# Autodesk Inventor assembly: Assembly1
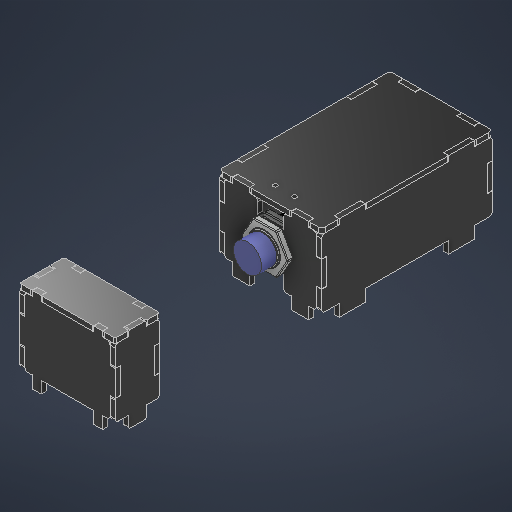
[picture p0: Inventor's stored thumbnail of the model, 512x512]
Saved by Autodesk Inventor 2027.1 (Build 311270010, 270A)
## iProperties
Created: 2026-10-16
Part Number: Assembly1
Document SubType Name: Assembly
Designer: SDS Scholar
Author: SDS Scholar
## Documents named in this file (12)
- C:\Users\Ahmed\Desktop\Fall 26\Design 1 Repo\MCT333_Design_of_Mechatronics_Systems_1\CAD\FEED and Sorting\sorting_area\SortingArea.iam
- C:\Users\Ahmed\Desktop\Fall 26\Design 1 Repo\MCT333_Design_of_Mechatronics_Systems_1\CAD\electronic_components\18mm-inductive-proximity-sensor-taiss-4\Inductive Proximity Sensor Assembly\Inductive Proximity Sensor Assembly.iam
- C:\Users\Ahmed\Desktop\Fall 26\Design 1 Repo\MCT333_Design_of_Mechatronics_Systems_1\CAD\FEED and Sorting\sorting_area\TransmitterFace.ipt
- C:\Users\Ahmed\Desktop\Fall 26\Design 1 Repo\MCT333_Design_of_Mechatronics_Systems_1\CAD\FEED and Sorting\sorting_area\SideFace.ipt
- C:\Users\Ahmed\Desktop\Fall 26\Design 1 Repo\MCT333_Design_of_Mechatronics_Systems_1\CAD\FEED and Sorting\sorting_area\BackFace.ipt
- C:\Users\Ahmed\Desktop\Fall 26\Design 1 Repo\MCT333_Design_of_Mechatronics_Systems_1\CAD\FEED and Sorting\sorting_area\TransmitterCeil.ipt
- C:\Users\Ahmed\Desktop\Fall 26\Design 1 Repo\MCT333_Design_of_Mechatronics_Systems_1\CAD\FEED and Sorting\sorting_area\RxFace.ipt
- C:\Users\Ahmed\Desktop\Fall 26\Design 1 Repo\MCT333_Design_of_Mechatronics_Systems_1\CAD\FEED and Sorting\sorting_area\RxBack.ipt
- C:\Users\Ahmed\Desktop\Fall 26\Design 1 Repo\MCT333_Design_of_Mechatronics_Systems_1\CAD\FEED and Sorting\sorting_area\LaserRxSlot.ipt
- C:\Users\Ahmed\Desktop\Fall 26\Design 1 Repo\MCT333_Design_of_Mechatronics_Systems_1\CAD\FEED and Sorting\sorting_area\RxSide.ipt
- C:\Users\Ahmed\Desktop\Fall 26\Design 1 Repo\MCT333_Design_of_Mechatronics_Systems_1\CAD\FEED and Sorting\sorting_area\RxCeil.ipt
- C:\Users\Ahmed\Desktop\Fall 26\Design 1 Repo\MCT333_Design_of_Mechatronics_Systems_1\CAD\FEED and Sorting\sorting_area\LaserRxSupport.ipt
## Components (13 placed, 11 different names)
1. TransmitterFace:1 — Mate:14, Mate:17, Mate:19, Mate:21, Mate:22, Angle:1, Flush:1, Flush:2, Flush:25, Flush:28, Flush:30, Flush:31, Flush:32, Mate:24, Flush:33
2. Inductive Proximity Sensor Assembly:1 [sub-assembly] — Mate:19, Mate:22, Angle:1, Mate:37
3. SideFace:1 — Flush:1, Flush:2, Flush:25, Flush:27, Flush:29, Mate:26
4. BackFace:1 — Flush:27, Flush:28, Flush:29
5. SideFace:2 — Flush:30, Flush:31, Flush:32
6. TransmitterCeil:1 — Mate:24, Flush:33, Mate:26
7. RxFace:1 — Mate:35, Mate:37, Flush:34, Mate:38, Mate:39, Flush:35, Flush:37, Flush:39, Flush:45, Flush:46, Mate:48, Mate:49
8. RxBack:1 — Mate:36, Flush:36, Flush:38, Flush:40, Flush:41, Flush:42, Flush:44
9. LaserRxSlot:1 — Flush:34, Mate:38, Mate:39
10. RxSide:1 — Flush:35, Flush:36, Flush:37, Flush:38, Flush:39, Mate:40, Flush:43
11. RxSide:2 — Flush:40, Flush:41, Flush:42
12. RxCeil:1 — Mate:40, Flush:43, Flush:44
13. LaserRxSupport:1 — Flush:46, Mate:48, Mate:49
## Relationships (39: Flush 23, Mate 15, Angle 1)
- Mate:14: TransmitterFace:1
- Mate:17: TransmitterFace:1
- Mate:19: TransmitterFace:1 ↔ Inductive Proximity Sensor Assembly:1
- Mate:21: TransmitterFace:1
- Mate:22: TransmitterFace:1 ↔ Inductive Proximity Sensor Assembly:1
- Angle:1 (0 deg): TransmitterFace:1 ↔ Inductive Proximity Sensor Assembly:1
- Flush:1: TransmitterFace:1 ↔ SideFace:1
- Flush:2: TransmitterFace:1 ↔ SideFace:1
- Flush:25: TransmitterFace:1 ↔ SideFace:1
- Flush:27: SideFace:1 ↔ BackFace:1
- Flush:28: TransmitterFace:1 ↔ BackFace:1
- Flush:29: SideFace:1 ↔ BackFace:1
- Flush:30: TransmitterFace:1 ↔ SideFace:2
- Flush:31: TransmitterFace:1 ↔ SideFace:2
- Flush:32: TransmitterFace:1 ↔ SideFace:2
- Mate:24: TransmitterFace:1 ↔ TransmitterCeil:1
- Flush:33: TransmitterFace:1 ↔ TransmitterCeil:1
- Mate:26: SideFace:1 ↔ TransmitterCeil:1
- Mate:35: RxFace:1
- Mate:36: RxBack:1
- Mate:37 (76.5 mm): Inductive Proximity Sensor Assembly:1 ↔ RxFace:1
- Flush:34: RxFace:1 ↔ LaserRxSlot:1
- Mate:38: RxFace:1 ↔ LaserRxSlot:1
- Mate:39: RxFace:1 ↔ LaserRxSlot:1
- Flush:35: RxFace:1 ↔ RxSide:1
- Flush:36: RxBack:1 ↔ RxSide:1
- Flush:37: RxFace:1 ↔ RxSide:1
- Flush:38: RxBack:1 ↔ RxSide:1
- Flush:39: RxFace:1 ↔ RxSide:1
- Flush:40: RxBack:1 ↔ RxSide:2
- Flush:41: RxBack:1 ↔ RxSide:2
- Flush:42: RxBack:1 ↔ RxSide:2
- Mate:40: RxSide:1 ↔ RxCeil:1
- Flush:43: RxSide:1 ↔ RxCeil:1
- Flush:44: RxBack:1 ↔ RxCeil:1
- Flush:45 (3 mm): RxFace:1
- Flush:46: RxFace:1 ↔ LaserRxSupport:1
- Mate:48: RxFace:1 ↔ LaserRxSupport:1
- Mate:49: RxFace:1 ↔ LaserRxSupport:1
